# Autodesk Inventor assembly: SPE11V1 Baranda Superior (soldadura)
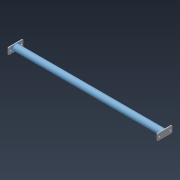
[picture p0: Inventor's stored thumbnail of the model, 180x180]
Saved by Autodesk Inventor 2021.2 (Build 252289000, 289)
## iProperties
Created: 2026-11-03
Part Number: SPE11V1 Baranda Superior (soldadura)
Document SubType Name: Assembly
Designer: Tecnica
Author: Tecnica
## Documents named in this file (3)
- C:\Users\Tecnica\OneDrive\Documentos\Mecanica\Soporte-Paciente-Espinografia\Workspace\SPE11V1 Baranda Superior (soldadura).iam
- C:\Users\Tecnica\OneDrive\Documentos\Mecanica\Soporte-Paciente-Espinografia\Workspace\SP37V1 Planchuela Baranda.ipt
- C:\Users\Tecnica\OneDrive\Documentos\Mecanica\Soporte-Paciente-Espinografia\Workspace\SP29V1 Tubo superior.ipt
## Components (3 placed, 2 different names)
1. SP29V1 Tubo superior:1
2. SP37V1 Planchuela Baranda:2
3. SP37V1 Planchuela Baranda:1
## Relationships (1: Mate 1)
- [Mate]: SP29V1 Tubo superior:1 ↔ SP37V1 Planchuela Baranda:2
